# Autodesk Inventor assembly: piping runs
(part 2 of 2)
Name: Hydraulikschlauch - SAE-Flansch-Verbindung
StartFittingKey: v3#933069c9-73b6-4141-af99-628d4a97b2c2#1
## Documents named in this file (1)
- C:\Users\mpfaff\Documents\CAD\Vorlagen\project_copy_template_2026\6_Vorlagen\Design Data\Tube & Pipe\de-DE\piping runs.iam
